# Autodesk Inventor assembly: Assembly v3 without mistakes (12-4 )
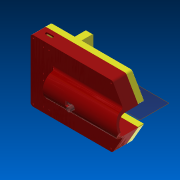
[picture p0: Inventor's stored thumbnail of the model, 180x180]
Saved by Autodesk Inventor 2019 (Build 230136000, 136)
## iProperties
Created: 2019-04-12
Part Number: Assembly v3 without mistakes (12-4 )
Document SubType Name: Assembly
Designer: --------
Author: --------
## Documents named in this file (5)
- G:\ASU\Sem8\Design of mecha\Pcleaner V3\PCleanerV3\Assembly v3 without mistakes (12-4 ).iam
- G:\ASU\Sem8\Design of mecha\Pcleaner V3\PCleanerV3\aquarium pump head.ipt
- G:\ASU\Sem8\Design of mecha\Pcleaner V3\PCleanerV3\new base.ipt
- G:\ASU\Sem8\Design of mecha\Pcleaner V3\PCleanerV3\Pump Holder.ipt
- G:\ASU\Sem8\Design of mecha\Pcleaner V3\PCleanerV3\Chassis - Edited - no height.ipt
## Components (4 placed, 4 different names)
1. aquarium pump head:1 — Mate:1, Mate:2, Mate:3, Mate:5
2. new base:1 — Mate:1, Mate:2, Mate:3, Mate:4, Mate:6, Flush:1, Flush:2
3. Pump Holder:1 — Mate:4, Mate:5
4. Chassis - edited - no height:1 — Mate:6, Flush:1, Flush:2
## Relationships (8: Mate 6, Flush 2)
- Mate:1: aquarium pump head:1 ↔ new base:1
- Mate:2: aquarium pump head:1 ↔ new base:1
- Mate:3: aquarium pump head:1 ↔ new base:1
- Mate:4: new base:1 ↔ Pump Holder:1
- Mate:5: aquarium pump head:1 ↔ Pump Holder:1
- Mate:6: new base:1 ↔ Chassis - edited - no height:1
- Flush:1: new base:1 ↔ Chassis - edited - no height:1
- Flush:2: new base:1 ↔ Chassis - edited - no height:1
